# Autodesk Inventor assembly: Frontal_Puertos
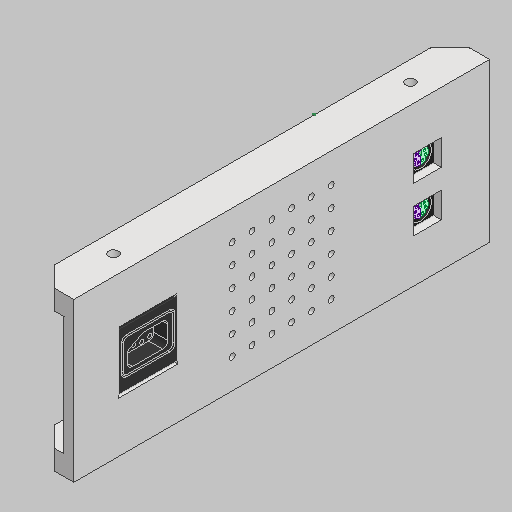
[picture p0: Inventor's stored thumbnail of the model, 512x512]
Saved by Autodesk Inventor 2027 (Build 310192000, 192)
## iProperties
Created: 2026-11-23
Part Number: Frontal_Puertos
Document SubType Name: Assembly
Designer: Alexander
Author: Alexander
## Documents named in this file (5)
- C:\Users\Alexander\Documents\Propuesta_Modelo_3D\Propuesta_Modelo_3D\Modelo V2\Frontal_Puertos.iam
- C:\Users\Alexander\Documents\Propuesta_Modelo_3D\Propuesta_Modelo_3D\Modelo V2\Puered_Puertos.ipt
- C:\Users\Alexander\Documents\Propuesta_Modelo_3D\Propuesta_Modelo_3D\Modelo V2\PS2.ipt
- C:\Users\Alexander\Documents\Propuesta_Modelo_3D\Propuesta_Modelo_3D\Modelo V2\Puerto_Unitario_Nes.ipt
- C:\Users\Alexander\Documents\Propuesta_Modelo_3D\Propuesta_Modelo_3D\Modelo V2\Bafle.ipt
## Components (5 placed, 4 different names)
1. Puered_Puertos:1 — Insertar:1, Insertar:2, Insertar:3, Insertar:4, Insertar:5, Insertar:6, Coincidencia:1
2. PS2:1 — Insertar:1, Insertar:2
3. Puerto_Unitario_Nes:1 — Insertar:5, Insertar:6
4. PS2:2 — Insertar:3, Insertar:4
5. Bafle:1 — Coincidencia:1
## Relationships (7: Insert 6, Mate 1)
- Insertar:1: Puered_Puertos:1 ↔ PS2:1
- Insertar:2: Puered_Puertos:1 ↔ PS2:1
- Insertar:3: Puered_Puertos:1 ↔ PS2:2
- Insertar:4: Puered_Puertos:1 ↔ PS2:2
- Insertar:5: Puered_Puertos:1 ↔ Puerto_Unitario_Nes:1
- Insertar:6: Puered_Puertos:1 ↔ Puerto_Unitario_Nes:1
- Coincidencia:1 [Mate]: Puered_Puertos:1 ↔ Bafle:1
